# Autodesk Inventor assembly: robotfish_new_1
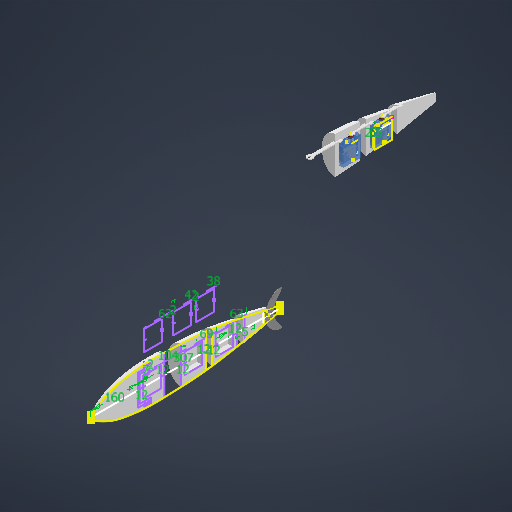
[picture p0: Inventor's stored thumbnail of the model, 512x512]
Saved by Autodesk Inventor 2027 (Build 310192060, 192F)
## iProperties
Created: 2026-08-14
Part Number: robotfish_new_1
Document SubType Name: Assembly
Designer: thita
Author: thita
## Documents named in this file (10)
- D:\Year2\đồ án tốt nghịp\đồ án tốt nghiệp v2\robotfish_new (2)\Workgroups\NotInProject\robotfish_new_1.iam
- D:\Year2\đồ án tốt nghịp\đồ án tốt nghiệp v2\robotfish_new (2)\Workgroups\NotInProject\main_body.ipt
- D:\Year2\đồ án tốt nghịp\đồ án tốt nghiệp v2\robotfish_new (2)\Workgroups\NotInProject\tail.ipt
- D:\Year2\đồ án tốt nghịp\đồ án tốt nghiệp v2\robotfish_new (2)\Workgroups\NotInProject\Assembly1.iam
- D:\Year2\đồ án tốt nghịp\đồ án tốt nghiệp v2\robotfish_new (2)\Workgroups\NotInProject\segment2.ipt
- D:\Year2\đồ án tốt nghịp\đồ án tốt nghiệp v2\robotfish_new (2)\Workgroups\NotInProject\segment3.ipt
- D:\Year2\đồ án tốt nghịp\đồ án tốt nghiệp v2\robotfish_new (2)\Workgroups\NotInProject\thanh lk.ipt
- D:\Year2\đồ án tốt nghịp\đồ án tốt nghiệp v2\robotfish_new (2)\Workgroups\NotInProject\thanh lk 1.ipt
- D:\Year2\đồ án tốt nghịp\đồ án tốt nghiệp v2\robotfish_new (2)\Workgroups\NotInProject\thanh lk 2.ipt
- D:\Year2\đồ án tốt nghịp\đồ án tốt nghiệp v2\vây đuôi phương án A.ipt
## Components (10 placed, 9 different names)
1. main_body:1 — Mate:1, Mate:2
2. Assembly1:10 [sub-assembly] — Rigid:2, Rigid:4
3. Assembly1:11 [sub-assembly] — Rigid:3, Rigid:5, Rotational:1
4. segment2:1 — Rigid:2
5. segment3:1 — Rigid:3
6. thanh lk:1 — Rigid:4
7. thanh lk 1:1 — Rigid:5
8. thanh lk 2:1 — Rotational:1
9. tail:1
10. vây đuôi phương án A:1 — Mate:1, Mate:2
## Relationships (7: WeldJoint 4, Mate 2, RevoluteJoint 1)
- Rigid:2 [WeldJoint]: Assembly1:10 ↔ segment2:1
- Rigid:3 [WeldJoint]: Assembly1:11 ↔ segment3:1
- Rigid:4 [WeldJoint]: Assembly1:10 ↔ thanh lk:1
- Rigid:5 [WeldJoint]: Assembly1:11 ↔ thanh lk 1:1
- Rotational:1 [RevoluteJoint]: Assembly1:11 ↔ thanh lk 2:1
- Mate:1 (2.5 mm): main_body:1 ↔ vây đuôi phương án A:1
- Mate:2: main_body:1 ↔ vây đuôi phương án A:1
## Named parameters: Finish1_Area = 81.013
note: some values were not read from the file. Shown as the stored number, unit unknown: "Finish1_Area".
